# Autodesk Inventor assembly: Assembly
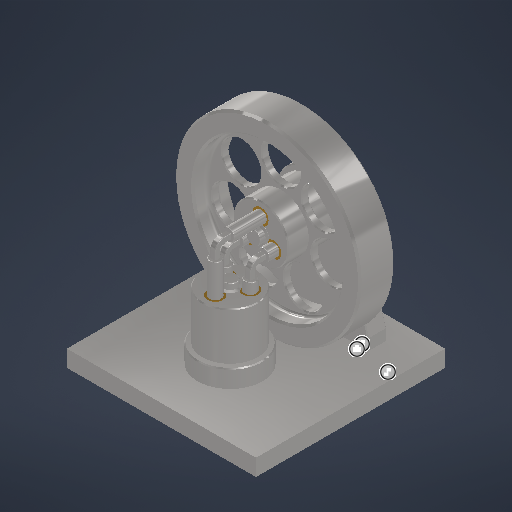
[picture p0: Inventor's stored thumbnail of the model, 512x512]
Saved by Autodesk Inventor 2026.3 (Build 303398000, 398)
## iProperties
Created: 2026-11-02
Part Number: Assembly
Document SubType Name: Assembly
Designer: ADMIN
Author: ADMIN
## Documents named in this file (11)
- E:\study\bách khoa\Vẽ\Bài tập\bản vẽ lắp\Cylinder Elbow Steam Engine\Assembly.iam
- C:\Users\ADMIN\Documents\Inventor\Content Center Files\R2026\en-US\ANSI B18.3.1M(1)\ANSI B18.3.1M - M4x0,7 x 12(2).ipt
- E:\study\bách khoa\Vẽ\Bài tập\bản vẽ lắp\Cylinder Elbow Steam Engine\Cylinder Shaft.ipt
- E:\study\bách khoa\Vẽ\Bài tập\bản vẽ lắp\Cylinder Elbow Steam Engine\Cylinder tube.ipt
- E:\study\bách khoa\Vẽ\Bài tập\bản vẽ lắp\Cylinder Elbow Steam Engine\Flywheel Stand.ipt
- E:\study\bách khoa\Vẽ\Bài tập\bản vẽ lắp\Cylinder Elbow Steam Engine\Flywheel with Cylinder.ipt
- E:\study\bách khoa\Vẽ\Bài tập\bản vẽ lắp\Cylinder Elbow Steam Engine\Piston.ipt
- E:\study\bách khoa\Vẽ\Bài tập\bản vẽ lắp\Cylinder Elbow Steam Engine\Port Block.ipt
- E:\study\bách khoa\Vẽ\Bài tập\bản vẽ lắp\Cylinder Elbow Steam Engine\Revolving cylinder body.ipt
- E:\study\bách khoa\Vẽ\Bài tập\bản vẽ lắp\Cylinder Elbow Steam Engine\Spring wave washer.ipt
- E:\study\bách khoa\Vẽ\Bài tập\bản vẽ lắp\Cylinder Elbow Steam Engine\Base plate.ipt
## Components (22 placed, 10 different names)
1. Broached Socket Head Cap Screw - Metric M4x0,7 x 12:1 — Mate:35, Mate:36
2. Broached Socket Head Cap Screw - Metric M4x0,7 x 12:2 — Mate:31, Mate:32
3. Broached Socket Head Cap Screw - Metric M4x0,7 x 12:3 — Mate:29, Mate:30
4. Broached Socket Head Cap Screw - Metric M4x0,7 x 12:4 — Mate:33, Mate:34
5. Cylinder Shaft:1 — Mate:39, Mate:40
6. Cylinder tube:1 — Mate:15, Mate:20, Flush:4
7. Flywheel Stand:1 — Mate:3, Mate:4, Mate:5, Mate:6, Mate:7
8. Flywheel with Cylinder:1 — Mate:6, Mate:7, Mate:9, Mate:10, Mate:11, Flush:3, Mate:17, Flush:7, Mate:24, Flush:8, Mate:26, Angle:1
9. Piston:1 — Mate:27, Mate:28
10. Port Block:1 — Mate:12, Mate:13, Mate:14, Mate:18, Mate:19
11. Revolving cylinder body:1 — Mate:18, Mate:19, Mate:20, Flush:4, Flush:5, Mate:21, Mate:22, Flush:6, Mate:37, Mate:38, Mate:39, Mate:40
12. Spring wave washer:1 — Mate:8, Mate:9, Mate:10
13. Base plate:1 — Flush:2, Mate:2, Mate:3, Mate:4, Mate:5, Mate:12, Mate:13, Mate:14, Mate:29, Mate:30, Mate:31, Mate:32, Mate:33, Mate:34, Mate:35, Mate:36
14. Cylinder Shaft:2 — Mate:8, Mate:11
15. Spring wave washer:2 — Mate:37, Mate:38
16. Cylinder tube:2 — Mate:16, Flush:3, Mate:17
17. Cylinder tube:3 — Flush:5, Mate:21, Mate:28
18. Cylinder tube:4 — Mate:22, Flush:6, Mate:23
19. Cylinder tube:5 — Flush:7, Mate:24, Mate:25
20. Cylinder tube:6 — Flush:8, Mate:26, Mate:27
21. Piston:2 — Mate:15, Mate:16
22. Piston:3 — Mate:23, Mate:25
## Relationships (47: Mate 39, Flush 7, Angle 1)
- Flush:2: Base plate:1
- Mate:2: Base plate:1
- Mate:3: Flywheel Stand:1 ↔ Base plate:1
- Mate:4: Flywheel Stand:1 ↔ Base plate:1
- Mate:5: Flywheel Stand:1 ↔ Base plate:1
- Mate:6: Flywheel Stand:1 ↔ Flywheel with Cylinder:1
- Mate:7: Flywheel Stand:1 ↔ Flywheel with Cylinder:1
- Mate:8: Spring wave washer:1 ↔ Cylinder Shaft:2
- Mate:9: Flywheel with Cylinder:1 ↔ Spring wave washer:1
- Mate:10: Flywheel with Cylinder:1 ↔ Spring wave washer:1
- Mate:11 (1 mm): Flywheel with Cylinder:1 ↔ Cylinder Shaft:2
- Mate:12: Port Block:1 ↔ Base plate:1
- Mate:13: Port Block:1 ↔ Base plate:1
- Mate:14: Port Block:1 ↔ Base plate:1
- Mate:15: Cylinder tube:1 ↔ Piston:2
- Mate:16: Cylinder tube:2 ↔ Piston:2
- Flush:3: Flywheel with Cylinder:1 ↔ Cylinder tube:2
- Mate:17: Flywheel with Cylinder:1 ↔ Cylinder tube:2
- Mate:18: Port Block:1 ↔ Revolving cylinder body:1
- Mate:19: Port Block:1 ↔ Revolving cylinder body:1
- Mate:20: Cylinder tube:1 ↔ Revolving cylinder body:1
- Flush:4: Cylinder tube:1 ↔ Revolving cylinder body:1
- Flush:5: Revolving cylinder body:1 ↔ Cylinder tube:3
- Mate:21: Revolving cylinder body:1 ↔ Cylinder tube:3
- Mate:22: Revolving cylinder body:1 ↔ Cylinder tube:4
- Flush:6: Revolving cylinder body:1 ↔ Cylinder tube:4
- Mate:23: Cylinder tube:4 ↔ Piston:3
- Flush:7: Flywheel with Cylinder:1 ↔ Cylinder tube:5
- Mate:24: Flywheel with Cylinder:1 ↔ Cylinder tube:5
- Mate:25: Cylinder tube:5 ↔ Piston:3
- Flush:8: Flywheel with Cylinder:1 ↔ Cylinder tube:6
- Mate:26: Flywheel with Cylinder:1 ↔ Cylinder tube:6
- Mate:27: Piston:1 ↔ Cylinder tube:6
- Mate:28: Piston:1 ↔ Cylinder tube:3
- Mate:29: Broached Socket Head Cap Screw - Metric M4x0,7 x 12:3 ↔ Base plate:1
- Mate:30: Broached Socket Head Cap Screw - Metric M4x0,7 x 12:3 ↔ Base plate:1
- Mate:31: Broached Socket Head Cap Screw - Metric M4x0,7 x 12:2 ↔ Base plate:1
- Mate:32: Broached Socket Head Cap Screw - Metric M4x0,7 x 12:2 ↔ Base plate:1
- Mate:33: Broached Socket Head Cap Screw - Metric M4x0,7 x 12:4 ↔ Base plate:1
- Mate:34: Broached Socket Head Cap Screw - Metric M4x0,7 x 12:4 ↔ Base plate:1
- Mate:35: Broached Socket Head Cap Screw - Metric M4x0,7 x 12:1 ↔ Base plate:1
- Mate:36: Broached Socket Head Cap Screw - Metric M4x0,7 x 12:1 ↔ Base plate:1
- Mate:37: Revolving cylinder body:1 ↔ Spring wave washer:2
- Mate:38: Revolving cylinder body:1 ↔ Spring wave washer:2
- Mate:39 (1 mm): Cylinder Shaft:1 ↔ Revolving cylinder body:1
- Mate:40: Cylinder Shaft:1 ↔ Revolving cylinder body:1
- Angle:1 (1800 deg): Flywheel with Cylinder:1
